# Autodesk Inventor assembly: assembly v5
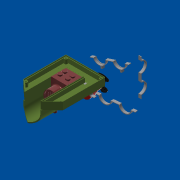
[picture p0: Inventor's stored thumbnail of the model, 180x180]
Saved by Autodesk Inventor 2019 (Build 230136000, 136)
## iProperties
Created: 2019-04-14
Part Number: assembly v5
Document SubType Name: Assembly
Designer: --------
Author: --------
## Documents named in this file (10)
- D:\(C)\Engineering\6.Senior 1\Semester 8\Design of MCT (2)\Electronics\PCleanerV5rar_2\PCleanerV3\assembly v5.iam
- D:\(C)\Engineering\6.Senior 1\Semester 8\Design of MCT (2)\Electronics\PCleanerV5rar_2\PCleanerV3\chassis v5.ipt
- D:\(C)\Engineering\6.Senior 1\Semester 8\Design of MCT (2)\Electronics\PCleanerV5rar_2\PCleanerV3\aquarium pump head.ipt
- D:\(C)\Engineering\6.Senior 1\Semester 8\Design of MCT (2)\Electronics\PCleanerV5rar_2\PCleanerV3\base v5.ipt
- D:\(C)\Engineering\6.Senior 1\Semester 8\Design of MCT (2)\Electronics\PCleanerV5rar_2\PCleanerV3\Bilge-pump.ipt
- D:\(C)\Engineering\6.Senior 1\Semester 8\Design of MCT (2)\Electronics\PCleanerV5rar_2\PCleanerV3\Foam v5.ipt
- D:\(C)\Engineering\6.Senior 1\Semester 8\Design of MCT (2)\Electronics\PCleanerV5rar_2\PCleanerV3\fork v5.ipt
- D:\(C)\Engineering\6.Senior 1\Semester 8\Design of MCT (2)\Electronics\PCleanerV5rar_2\PCleanerV3\plates.ipt
- D:\(C)\Engineering\6.Senior 1\Semester 8\Design of MCT (2)\Electronics\PCleanerV5rar_2\PCleanerV3\prop.ipt
- D:\(C)\Engineering\6.Senior 1\Semester 8\Design of MCT (2)\Electronics\PCleanerV5rar_2\PCleanerV3\truss upper v5.ipt
## Components (14 placed, 9 different names)
1. aquarium pump head:1 — Mate:4, Mate:15, Angle:3
2. base v5:1 — Mate:4, Flush:1, Flush:2, Mate:5, Mate:10, Flush:3, Flush:4, Angle:2, Mate:15, Angle:3, Mate:19, Mate:20
3. chassis v5:1 — Flush:1, Flush:2, Mate:5
4. Bilge-pump:1 — Mate:13, Mate:14, Mate:23, Mate:24, Mate:28
5. Bilge-pump:2 — Mate:21, Mate:22, Mate:27
6. Foam v5:1 — Mate:10, Flush:3, Flush:4
7. fork v5:1 — Mate:13
8. fork v5:2 — Mate:14, Angle:2, Mate:28
9. plates:2 — Mate:19, Flush:16
10. plates:4 — Flush:16, Mate:20
11. prop:1 — Mate:23, Mate:24
12. prop:2 — Mate:21, Mate:22
13. truss upper v5:1 — Mate:27
14. truss upper v5:2
## Relationships (21: Mate 14, Flush 5, Angle 2)
- Mate:4: aquarium pump head:1 ↔ base v5:1
- Flush:1: base v5:1 ↔ chassis v5:1
- Flush:2: base v5:1 ↔ chassis v5:1
- Mate:5: base v5:1 ↔ chassis v5:1
- Mate:10: base v5:1 ↔ Foam v5:1
- Flush:3: base v5:1 ↔ Foam v5:1
- Flush:4: base v5:1 ↔ Foam v5:1
- Mate:13: Bilge-pump:1 ↔ fork v5:1
- Mate:14: Bilge-pump:1 ↔ fork v5:2
- Angle:2 (180 deg): base v5:1 ↔ fork v5:2
- Mate:15: aquarium pump head:1 ↔ base v5:1
- Angle:3 (180 deg): aquarium pump head:1 ↔ base v5:1
- Mate:19: base v5:1 ↔ plates:2
- Flush:16: plates:2 ↔ plates:4
- Mate:20: base v5:1 ↔ plates:4
- Mate:21: Bilge-pump:2 ↔ prop:2
- Mate:22: Bilge-pump:2 ↔ prop:2
- Mate:23: Bilge-pump:1 ↔ prop:1
- Mate:24: Bilge-pump:1 ↔ prop:1
- Mate:27: Bilge-pump:2 ↔ truss upper v5:1
- Mate:28: Bilge-pump:1 ↔ fork v5:2
